# Autodesk Inventor assembly: 1_1_charniere
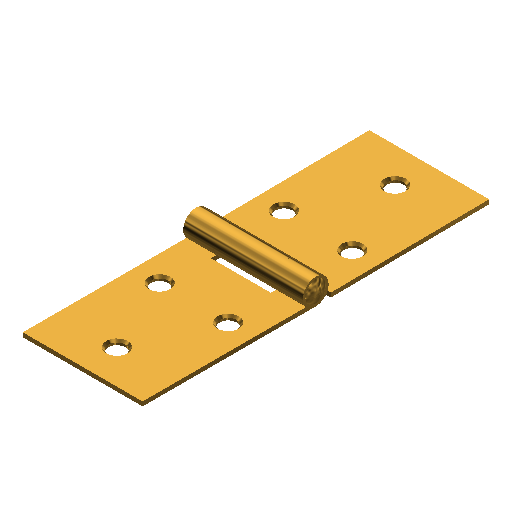
[picture p0: Inventor's stored thumbnail of the model, 512x512]
Saved by Autodesk Inventor 2026 (Build 300175000, 175)
## iProperties
Created: 2025-05-01
Part Number: 1_1_charniere
Document SubType Name: Assembly
Designer: AdminForWorker
Title: 1_1_charniere v3
Author: AdminForWorker
## Documents named in this file (4)
- C:\Users\remg9\OneDrive - HESSO\P2511_Dossier_partage_RVEZ\01_Robot\0101_CAO\01_pont\1_1_charniere.iam
- C:\Users\remg9\OneDrive - HESSO\P2511_Dossier_partage_RVEZ\01_Robot\0101_CAO\01_pont\1_1_1_1_paumelle_ext.ipt
- C:\Users\remg9\OneDrive - HESSO\P2511_Dossier_partage_RVEZ\01_Robot\0101_CAO\01_pont\1_1_1_2_paumelle_int.ipt
- C:\Users\remg9\OneDrive - HESSO\P2511_Dossier_partage_RVEZ\01_Robot\0101_CAO\01_pont\1_1_1_3_axe.ipt
## Components (3 placed, 3 different names)
1. 1_1_1_1_paumelle_ext:1 — Mate:1, Mate:2, Insert:1, Insert:2
2. 1_1_1_2_paumelle_int:1 — Mate:2, Insert:2
3. 1_1_1_3_axe:1 — Mate:1, Insert:1
## Relationships (4: Mate 2, Insert 2)
- Mate:1: 1_1_1_1_paumelle_ext:1 ↔ 1_1_1_3_axe:1
- Mate:2: 1_1_1_1_paumelle_ext:1 ↔ 1_1_1_2_paumelle_int:1
- Insert:1: 1_1_1_1_paumelle_ext:1 ↔ 1_1_1_3_axe:1
- Insert:2: 1_1_1_1_paumelle_ext:1 ↔ 1_1_1_2_paumelle_int:1
